# Autodesk Inventor assembly: XT30-6
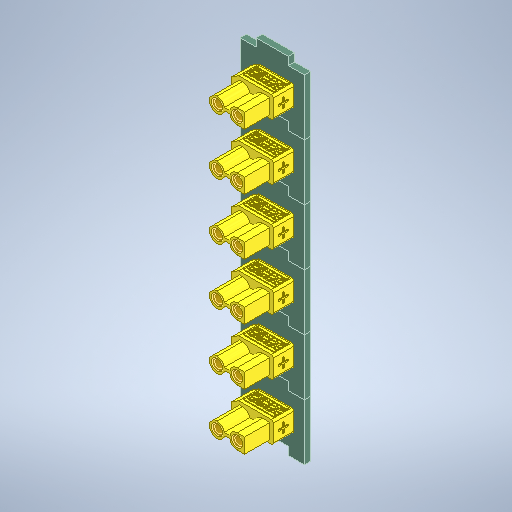
[picture p0: Inventor's stored thumbnail of the model, 512x512]
Saved by Autodesk Inventor 2025.3 (Build 293356030, 356C)
## iProperties
Created: 2025-09-04
Part Number: XT30-6
Document SubType Name: Assembly
Designer: ibuki_ono
Author: ibuki_ono
## Documents named in this file (2)
- C:\Users\ibuki_ono\Documents\hobby\rogiken\catchrobo\CAD\Hardware_CAD\Inventor\circuit\XT30-hub\XT30-hub\XT30-6.iam
- C:\Users\ibuki_ono\Documents\hobby\rogiken\catchrobo\CAD\Hardware_CAD\Inventor\circuit\XT30-hub\XT30-hub\XT30-hub.iam
## Components (6 placed, 1 different names)
1. XT30-hub:1 [sub-assembly]
2. XT30-hub:2 [sub-assembly]
3. XT30-hub:3 [sub-assembly]
4. XT30-hub:4 [sub-assembly]
5. XT30-hub:5 [sub-assembly]
6. XT30-hub:6 [sub-assembly]
## Component patterns: (6 elements, first: XT30-hub:1)
